# Autodesk Inventor assembly: DMF-1600 front connector
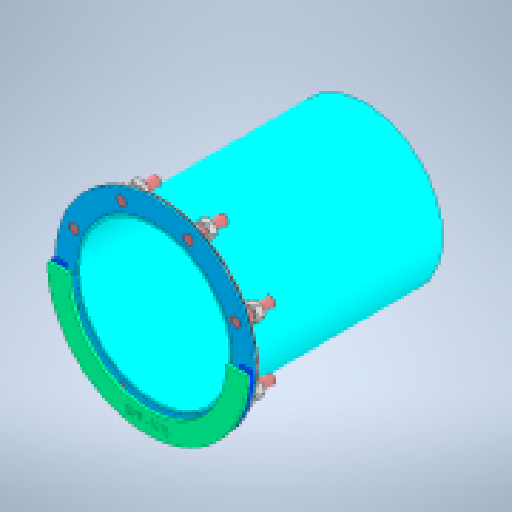
[picture p0: Inventor's stored thumbnail of the model, 512x512]
Saved by Autodesk Inventor 2026.2 (Build 302298000, 298)
## iProperties
Created: 2026-11-14
Part Number: DMF-1600 front connector
Document SubType Name: Assembly
Designer: admin
Author: admin
## Documents named in this file (8)
- C:\Users\admin\Documents\Inventor\DMF-Disk-Micro-Filter\DMF-1600 front connector.iam
- C:\Users\admin\Documents\Inventor\DMF-Disk-Micro-Filter\Барабан v2.1\DMF-16xx cjnnector ring.ipt
- C:\Users\admin\Documents\Inventor\DMF-Disk-Micro-Filter\DMF-16xx connector tube.ipt
- C:\Users\admin\Documents\Inventor\DMF-Disk-Micro-Filter\Архив\ДМФ 043 шпилька 2 v2.0.ipt
- C:\Users\admin\Documents\Inventor\DMF-Disk-Micro-Filter\Барабан v2.1\DMF-16xx front connector rrubber seal.ipt
- C:\Users\admin\Documents\Inventor\DMF-Disk-Micro-Filter\Барабан v2.1\DMF-16xx front connector ring 2.ipt
- C:\Users\admin\Documents\Inventor\DMF-Disk-Micro-Filter\ContentCenter\en-US\DIN EN ISO 4032\DIN EN ISO 4032 - M8.ipt
- C:\Users\admin\Documents\Inventor\DMF-Disk-Micro-Filter\Барабан v2.1\DMF-1613 front connector ring 3 half .ipt
## Components (21 placed, 7 different names)
1. DMF-1xxx :1 — Rigid:1, Flush:1, Flush:2, Flush:3, Rigid:2, Rigid:3, Rigid:4, Rigid:5, Rigid:6, Rigid:7, Rigid:8, Rigid:9, Rigid:10, Rigid:18
2. DMF-16xx connector tube:1 — Rigid:1
3. ДМФ 043 шпилька 2 v2.0:1 — Rigid:4, Rigid:11
4. ДМФ 043 шпилька 2 v2.0:2 — Rigid:5, Rigid:15
5. ДМФ 043 шпилька 2 v2.0:3 — Rigid:6, Rigid:16
6. ДМФ 043 шпилька 2 v2.0:4 — Rigid:10
7. ДМФ 043 шпилька 2 v2.0:5 — Rigid:9, Rigid:13
8. ДМФ 043 шпилька 2 v2.0:6 — Rigid:3, Rigid:12
9. ДМФ 043 шпилька 2 v2.0:7 — Rigid:7, Rigid:17
10. ДМФ 043 шпилька 2 v2.0:8 — Rigid:8, Rigid:14
11. DMF-16xx front connector rrubber seal:1 — Rigid:18
12. DMF-16xx front connector ring 2:1 — Rigid:2
13. DIN EN ISO 4032 M8:1
14. DIN EN ISO 4032 M8:2 — Rigid:11
15. DIN EN ISO 4032 M8:3 — Rigid:12
16. DIN EN ISO 4032 M8:4 — Rigid:14
17. DIN EN ISO 4032 M8:5 — Rigid:13
18. DIN EN ISO 4032 M8:6 — Rigid:17
19. DIN EN ISO 4032 M8:7 — Rigid:16
20. DIN EN ISO 4032 M8:8 — Rigid:15
21. DMF-1613 front connector ring 3 half :1
## Relationships (22: WeldJoint 18, Flush 3, CylindricalJoint 1)
- Rigid:1 [WeldJoint]: DMF-1xxx :1 ↔ DMF-16xx connector tube:1
- Flush:1: DMF-1xxx :1
- Flush:2: DMF-1xxx :1
- Flush:3: DMF-1xxx :1
- Rigid:2 [WeldJoint]: DMF-1xxx :1 ↔ DMF-16xx front connector ring 2:1
- Rigid:3 [WeldJoint]: DMF-1xxx :1 ↔ ДМФ 043 шпилька 2 v2.0:6
- Rigid:4 [WeldJoint]: DMF-1xxx :1 ↔ ДМФ 043 шпилька 2 v2.0:1
- Rigid:5 [WeldJoint]: DMF-1xxx :1 ↔ ДМФ 043 шпилька 2 v2.0:2
- Rigid:6 [WeldJoint]: DMF-1xxx :1 ↔ ДМФ 043 шпилька 2 v2.0:3
- Rigid:7 [WeldJoint]: DMF-1xxx :1 ↔ ДМФ 043 шпилька 2 v2.0:7
- Rigid:8 [WeldJoint]: DMF-1xxx :1 ↔ ДМФ 043 шпилька 2 v2.0:8
- Rigid:9 [WeldJoint]: DMF-1xxx :1 ↔ ДМФ 043 шпилька 2 v2.0:5
- Rigid:10 [WeldJoint]: DMF-1xxx :1 ↔ ДМФ 043 шпилька 2 v2.0:4
- [CylindricalJoint]: ДМФ 043 шпилька 2 v2.0:4 ↔ DIN EN ISO 4032 M8:1
- Rigid:11 [WeldJoint]: ДМФ 043 шпилька 2 v2.0:1 ↔ DIN EN ISO 4032 M8:2
- Rigid:12 [WeldJoint]: ДМФ 043 шпилька 2 v2.0:6 ↔ DIN EN ISO 4032 M8:3
- Rigid:13 [WeldJoint]: ДМФ 043 шпилька 2 v2.0:5 ↔ DIN EN ISO 4032 M8:5
- Rigid:14 [WeldJoint]: ДМФ 043 шпилька 2 v2.0:8 ↔ DIN EN ISO 4032 M8:4
- Rigid:15 [WeldJoint]: ДМФ 043 шпилька 2 v2.0:2 ↔ DIN EN ISO 4032 M8:8
- Rigid:16 [WeldJoint]: ДМФ 043 шпилька 2 v2.0:3 ↔ DIN EN ISO 4032 M8:7
- Rigid:17 [WeldJoint]: ДМФ 043 шпилька 2 v2.0:7 ↔ DIN EN ISO 4032 M8:6
- Rigid:18 [WeldJoint]: DMF-1xxx :1 ↔ DMF-16xx front connector rrubber seal:1
